# Autodesk Inventor assembly: Particle Accelerator Modell
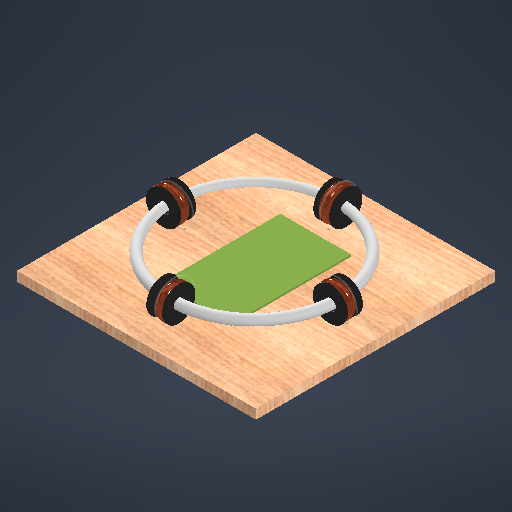
[picture p0: Inventor's stored thumbnail of the model, 512x512]
Saved by Autodesk Inventor 2026.2 (Build 302298010, 298A)
## iProperties
Created: 2026-10-05
Part Number: Particle Accelerator Modell
Document SubType Name: Assembly
Designer: denis
Mass: 6936.45 g
Surface Area: 8309.99 cm^2
Volume: 5487.76 cm^3
Density: 1.26399 g/cm^3
Author: denis
## Documents named in this file (6)
- C:\Users\denis\OneDrive\Documents\Inventor\Particle Accelerator Model\Particle Accelerator Model Assembly.iam
- C:\Users\denis\OneDrive\Documents\Inventor\Particle Accelerator Model\CAD\Base plate.ipt
- C:\Users\denis\OneDrive\Documents\Inventor\Particle Accelerator Model\CAD\Track and coil spools.iam
- C:\Users\denis\OneDrive\Documents\Inventor\Particle Accelerator Model\CAD\Zip tie.ipt
- C:\Users\denis\OneDrive\Documents\Inventor\Particle Accelerator Model\CAD\Circuit board.ipt
- C:\Users\denis\OneDrive\Documents\Inventor\Particle Accelerator Model\CAD\Copper coil.ipt
## Components (11 placed, 5 different names)
1. Basis:1 — Winkel:1, Passend:1, Passend:2, Passend:3, Passend:4, Passend:5, Passend:6, Starr:1
2. Bahn+Spulenhalterungen:1 [sub-assembly] — Winkel:1, Passend:7, Passend:8, Passend:9
3. Kabelbinder 2.0:1 — Passend:1
4. Kabelbinder 2.0:2 — Passend:2
5. Kabelbinder 2.0:3 — Passend:3, Passend:4
6. Kabelbinder 2.0:4 — Passend:5, Passend:6
7. Platine:1 — Starr:1
8. Kupfer:1
9. Kupfer:2 — Passend:8
10. Kupfer:3 — Passend:7
11. Kupfer:4 — Passend:9
## Relationships (11: Mate 9, Angle 1, WeldJoint 1)
- Winkel:1 [Angle] (0 deg): Basis:1 ↔ Bahn+Spulenhalterungen:1
- Passend:1 [Mate]: Basis:1 ↔ Kabelbinder 2.0:1
- Passend:2 [Mate]: Basis:1 ↔ Kabelbinder 2.0:2
- Passend:3 [Mate]: Basis:1 ↔ Kabelbinder 2.0:3
- Passend:4 [Mate]: Basis:1 ↔ Kabelbinder 2.0:3
- Passend:5 [Mate]: Basis:1 ↔ Kabelbinder 2.0:4
- Passend:6 [Mate]: Basis:1 ↔ Kabelbinder 2.0:4
- Starr:1 [WeldJoint]: Basis:1 ↔ Platine:1
- Passend:7 [Mate]: Bahn+Spulenhalterungen:1 ↔ Kupfer:3
- Passend:8 [Mate]: Bahn+Spulenhalterungen:1 ↔ Kupfer:2
- Passend:9 [Mate]: Bahn+Spulenhalterungen:1 ↔ Kupfer:4
